# Autodesk Inventor assembly: Enclosure
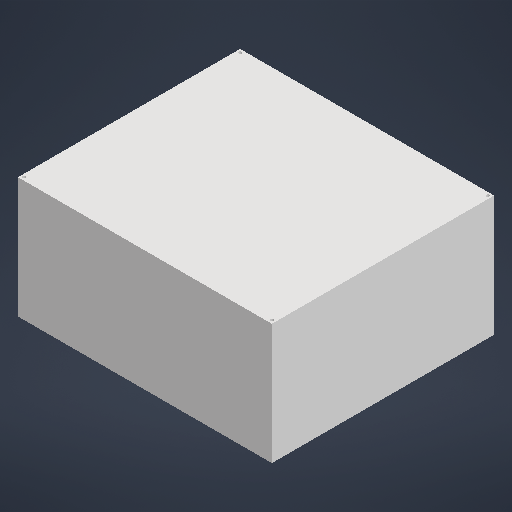
[picture p0: Inventor's stored thumbnail of the model, 512x512]
Saved by Autodesk Inventor 2026.2 (Build 302298010, 298A)
## iProperties
Created: 2026-03-26
Part Number: Enclosure
Document SubType Name: Assembly
Designer: User
Author: User
## Documents named in this file (3)
- D:\Autodesk Invento Pro Work\Honours Project\Assemblies\Enclosure.iam
- D:\Autodesk Invento Pro Work\Honours Project\Parts\Enclosure Box.ipt
- D:\Autodesk Invento Pro Work\Honours Project\Parts\Enclosure Lid.ipt
## Components (2 placed, 2 different names)
1. Enclosure Box:1 — Mate:1
2. Enclosure Lid:1 — Mate:1
## Relationships (1: Mate 1)
- Mate:1: Enclosure Box:1 ↔ Enclosure Lid:1
